# Autodesk Inventor assembly: harmonic
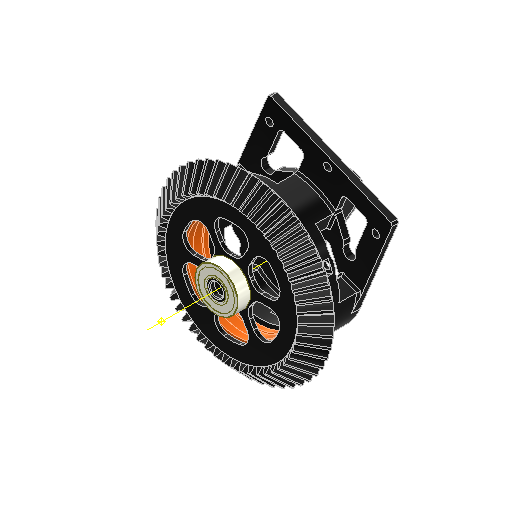
[picture p0: Inventor's stored thumbnail of the model, 512x512]
Saved by Autodesk Inventor 2025.3 (Build 293356030, 356C)
## iProperties
Created: 2026-04-01
Part Number: harmonic
Document SubType Name: Assembly
Designer: ibuki_ono
Author: ibuki_ono
## Documents named in this file (5)
- C:\Users\ibuki_ono\Documents\hobby\rogiken\catchrobo\2026_CAD\Hardware_2026\Inventor\End-Effector\harmonic.iam
- C:\Users\ibuki_ono\Documents\hobby\rogiken\catchrobo\2026_CAD\Hardware_2026\Inventor\End-Effector\outer_x1.ipt
- C:\Users\ibuki_ono\Documents\hobby\rogiken\catchrobo\2026_CAD\Hardware_2026\Inventor\End-Effector\unbrella\main-gear\デザイン アクセラレータ\かさ歯車11.ipt
- C:\Users\ibuki_ono\Documents\hobby\rogiken\catchrobo\2026_CAD\Hardware_2026\Inventor\End-Effector\bearing-8-19.ipt
- C:\Users\ibuki_ono\Documents\hobby\rogiken\catchrobo\2026_CAD\Hardware_2026\Inventor\End-Effector\inner_x2-extend.ipt
## Components (4 placed, 4 different names)
1. outer_x1:1 — メイト:4
2. かさ歯車1:1 — 挿入:1, メイト:4, 挿入:2
3. bearing-8-19:1 — 挿入:1
4. inner_x2-extend:1 — 挿入:2
## Relationships (3: Insert 2, Mate 1)
- 挿入:1 [Insert]: かさ歯車1:1 ↔ bearing-8-19:1
- メイト:4 [Mate] (0.5 mm): outer_x1:1 ↔ かさ歯車1:1
- 挿入:2 [Insert]: かさ歯車1:1 ↔ inner_x2-extend:1
